# Autodesk Inventor assembly: Assely_Curve_Liner_Slope
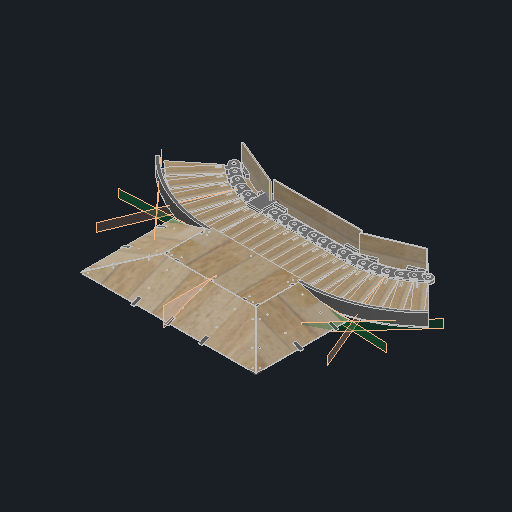
[picture p0: Inventor's stored thumbnail of the model, 512x512]
Saved by Autodesk Inventor 2027.1 (Build 311270010, 270A)
## iProperties
Created: 2026-10-11
Part Number: Assely_Curve_Liner_Slope
Document SubType Name: Assembly
Designer: takuya
Author: takuya
## Documents named in this file (3)
- D:\model\D2_Conveyor_2026\Assely_Curve_Liner_Slope.iam
- D:\model\D2_Conveyor_2026\liniar_module\Assy_linear_module_Slope.iam
- D:\model\D2_Conveyor_2026\curve_module\Assy_curve_module.iam
## Components (3 placed, 2 different names)
1. Assy_linear_module_Slope:1 [sub-assembly] — メイト:4, フラッシュ:2, メイト:5, メイト:6, フラッシュ:3, 角度:1
2. Assy_curve_module:2 [sub-assembly] — メイト:4, フラッシュ:2, メイト:5
3. Assy_curve_module:3 [sub-assembly] — メイト:6, フラッシュ:3, 角度:1
## Relationships (6: Mate 3, Flush 2, Angle 1)
- メイト:4 [Mate]: Assy_linear_module_Slope:1 ↔ Assy_curve_module:2
- フラッシュ:2 [Flush]: Assy_linear_module_Slope:1 ↔ Assy_curve_module:2
- メイト:5 [Mate]: Assy_linear_module_Slope:1 ↔ Assy_curve_module:2
- メイト:6 [Mate]: Assy_linear_module_Slope:1 ↔ Assy_curve_module:3
- フラッシュ:3 [Flush]: Assy_linear_module_Slope:1 ↔ Assy_curve_module:3
- 角度:1 [Angle] (180 deg): Assy_linear_module_Slope:1 ↔ Assy_curve_module:3
